# Autodesk Inventor assembly: result-entity
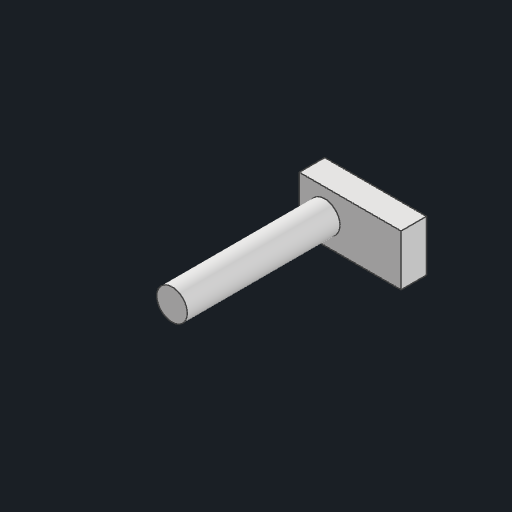
[picture p0: Inventor's stored thumbnail of the model, 512x512]
Saved by Autodesk Inventor 2026.1 (Build 301233000, 233)
## iProperties
Created: 2026-10-30
Part Number: result-entity
Document SubType Name: Assembly
Designer: anony
Author: anony
## Documents named in this file (3)
- C:\Users\anony\OneDrive\Desktop\AI Projects\CAD Convert\corpus\generated\asmimate\result-entity.iam
- C:\Users\anony\OneDrive\Desktop\AI Projects\CAD Convert\corpus\generated\imate\mate.ipt
- C:\Users\anony\OneDrive\Desktop\AI Projects\CAD Convert\corpus\generated\asmparts\box.ipt
## Components (2 placed, 2 different names)
1. mate:1 — Mate:1
2. box:1 — Mate:1
## Relationships (1: Mate 1)
- Mate:1: mate:1 ↔ box:1
